# Autodesk Inventor assembly: MM0937AN106_G25_001
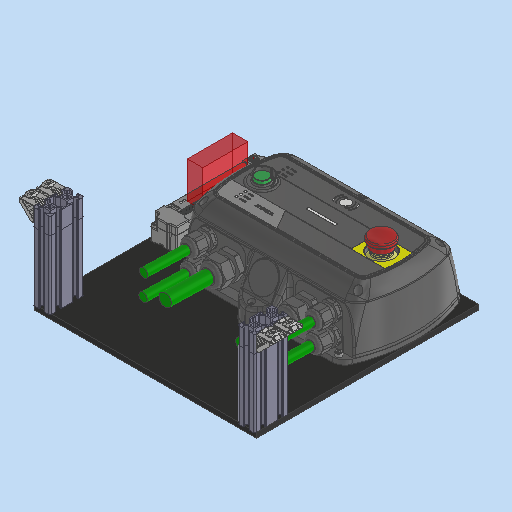
[picture p0: Inventor's stored thumbnail of the model, 512x512]
Saved by Autodesk Inventor 2023.3 (Build 273359000, 359)
## iProperties
Created: 2023-11-09
Part Number: MM0937AN106_G25_001
Description: =<RBPARTNOTITLE2>
Document SubType Name: Assembly
Designer: FSM9BW
Mass: 750.545 g
Surface Area: 2792.27 cm^2
Volume: 521.599 cm^3
Density: 1.43893 g/cm^3
RBPARTMADEOF: --
RBDRAWINGMISSINGSPEC: --
AnP_Kategorie: 99
RBPARTNOTITLE2: Halterung KeTop Bluetooth Modul
RBSURFACE: --
RBPARTNOTITLE1: fixture KeTop Bluetooth Modul
AnP_Material: =<Material>
RBMATERIAL: =<Material>
RBMATNO: =<Part Number>
RBPARTNO: SIEHE MNR
Author: FSM9BW
Keywords: =<RBPARTMADEOF>
Comments: =<RBSURFACE2>
Revision Number: 01
## Documents named in this file (10)
- C:\Users\rea9an\Documents\Inventor\TCAI2412_te1910_EM\AS00000913.iam
- C:\Users\rea9an\Documents\Inventor\TCAI2412_te1910_EM\PT00004562.ipt
- C:\Users\rea9an\Documents\Inventor\TCAI2412_te1910_EM\PT00004723.ipt
- C:\Users\rea9an\Documents\Inventor\TCAI2412_te1910_EM\PT00004537.ipt
- C:\Users\rea9an\Documents\Inventor\TCAI2412_te1910_EM\PT00004563.ipt
- C:\Users\rea9an\Documents\Inventor\TCAI2412_te1910_EM\PT00004297.ipt
- C:\Users\rea9an\Documents\Inventor\TCAI2412_te1910_EM\PT00004835.ipt
- C:\Users\rea9an\Documents\Inventor\TCAI2412_te1910_EM\PT00004860.ipt
- C:\Users\rea9an\Documents\Inventor\TCAI2412_te1910_EM\PT00004866.ipt
- C:\Users\rea9an\Documents\Inventor\TCAI2412_te1910_EM\PT00004564.ipt
## Components (20 placed, 9 different names)
1. PT00004562:1 — Einfügen:1, Einfügen:2, Einfügen:3, Einfügen:4, Einfügen:5, Einfügen:6, Passend:1, Passend:2, Einfügen:7, Einfügen:8, Einfügen:9, Einfügen:10, Fluchtend:7, Fluchtend:8
2. PT00004723:1 — Einfügen:1, Einfügen:2, Einfügen:13, Einfügen:14, Einfügen:15, Einfügen:16
3. PT00004537:1 — Einfügen:3, Einfügen:4, Einfügen:11, Einfügen:12, Passend:9
4. PT00004563:1 — Einfügen:5, Passend:2, Passend:7, Fluchtend:3, Fluchtend:4, Passend:8, Fluchtend:5, Fluchtend:6
5. PT00004563:2 — Einfügen:6, Passend:1, Passend:3, Fluchtend:1, Passend:4, Passend:5, Fluchtend:2, Passend:6
6. PT00004297:1 — Passend:3, Fluchtend:1, Passend:4
7. PT00004297:2 — Passend:7, Fluchtend:3, Fluchtend:4
8. PT00004297:3 — Passend:5, Fluchtend:2, Passend:6
9. PT00004297:4 — Passend:8, Fluchtend:5, Fluchtend:6
10. PT00004835:1 — Einfügen:7
11. PT00004835:2 — Einfügen:8
12. PT00004835:3 — Einfügen:9
13. PT00004835:4 — Einfügen:10
14. PT00004860:1 — Einfügen:11
15. PT00004860:2 — Einfügen:12
16. PT00004866:1 — Einfügen:13
17. PT00004866:2 — Einfügen:14
18. PT00004866:3 — Einfügen:16
19. PT00004866:4 — Einfügen:15
20. PT00004564:1 — Passend:9, Fluchtend:7, Fluchtend:8
## Relationships (33: Insert 16, Mate 9, Flush 8)
- Einfügen:1 [Insert]: PT00004562:1 ↔ PT00004723:1
- Einfügen:2 [Insert]: PT00004562:1 ↔ PT00004723:1
- Einfügen:3 [Insert]: PT00004562:1 ↔ PT00004537:1
- Einfügen:4 [Insert]: PT00004562:1 ↔ PT00004537:1
- Einfügen:5 [Insert]: PT00004562:1 ↔ PT00004563:1
- Einfügen:6 [Insert]: PT00004562:1 ↔ PT00004563:2
- Passend:1 [Mate]: PT00004562:1 ↔ PT00004563:2
- Passend:2 [Mate]: PT00004562:1 ↔ PT00004563:1
- Passend:3 [Mate]: PT00004563:2 ↔ PT00004297:1
- Fluchtend:1 [Flush]: PT00004563:2 ↔ PT00004297:1
- Passend:4 [Mate] (10 mm): PT00004563:2 ↔ PT00004297:1
- Passend:5 [Mate]: PT00004563:2 ↔ PT00004297:3
- Fluchtend:2 [Flush]: PT00004563:2 ↔ PT00004297:3
- Passend:6 [Mate] (-10 mm): PT00004563:2 ↔ PT00004297:3
- Passend:7 [Mate]: PT00004563:1 ↔ PT00004297:2
- Fluchtend:3 [Flush]: PT00004563:1 ↔ PT00004297:2
- Fluchtend:4 [Flush] (-10 mm): PT00004563:1 ↔ PT00004297:2
- Passend:8 [Mate]: PT00004563:1 ↔ PT00004297:4
- Fluchtend:5 [Flush]: PT00004563:1 ↔ PT00004297:4
- Fluchtend:6 [Flush] (10 mm): PT00004563:1 ↔ PT00004297:4
- Einfügen:7 [Insert]: PT00004562:1 ↔ PT00004835:1
- Einfügen:8 [Insert]: PT00004562:1 ↔ PT00004835:2
- Einfügen:9 [Insert]: PT00004562:1 ↔ PT00004835:3
- Einfügen:10 [Insert]: PT00004562:1 ↔ PT00004835:4
- Einfügen:11 [Insert]: PT00004537:1 ↔ PT00004860:1
- Einfügen:12 [Insert]: PT00004537:1 ↔ PT00004860:2
- Einfügen:13 [Insert]: PT00004723:1 ↔ PT00004866:1
- Einfügen:14 [Insert]: PT00004723:1 ↔ PT00004866:2
- Einfügen:15 [Insert]: PT00004723:1 ↔ PT00004866:4
- Einfügen:16 [Insert]: PT00004723:1 ↔ PT00004866:3
- Passend:9 [Mate]: PT00004537:1 ↔ PT00004564:1
- Fluchtend:7 [Flush] (38 mm): PT00004562:1 ↔ PT00004564:1
- Fluchtend:8 [Flush] (10 mm): PT00004562:1 ↔ PT00004564:1
